# Autodesk Inventor assembly: WAS-Assembly
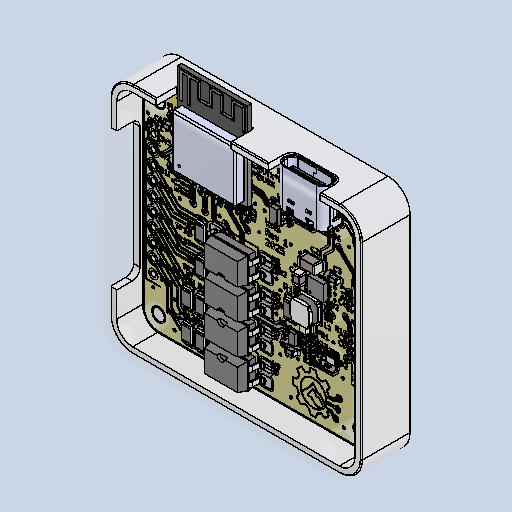
[picture p0: Inventor's stored thumbnail of the model, 512x512]
Saved by Autodesk Inventor 2027.1 (Build 311270010, 270A)
## iProperties
Created: 2025-09-30
Part Number: WAS-Assembly
Document SubType Name: Assembly
Designer: K. Paulsen
Author: K. Paulsen
## Documents named in this file (4)
- C:\repo\WAS\CAD\WAS-Assembly.iam
- C:\repo\WAS\CAD\WAS-PCB\WAS-PCB\WAS-PCB.iam
- C:\repo\WAS\CAD\WAS-Enclosure-Bottom.ipt
- C:\repo\WAS\CAD\WAS-Enclosure-Top.ipt
## Components (3 placed, 3 different names)
1. WAS-PCB:1 [sub-assembly] — Mate:1, Flush:1, Mate:2, Flush:4, Flush:5
2. WAS-Enclosure-Bottom:1 — Flush:2, Flush:3
3. WAS-Enclosure-Top:1 — Flush:3, Flush:4, Flush:5
## Relationships (7: Flush 5, Mate 2)
- Mate:1 (2 mm): WAS-PCB:1
- Flush:1: WAS-PCB:1
- Mate:2: WAS-PCB:1
- Flush:2: WAS-Enclosure-Bottom:1
- Flush:3: WAS-Enclosure-Bottom:1 ↔ WAS-Enclosure-Top:1
- Flush:4: WAS-PCB:1 ↔ WAS-Enclosure-Top:1
- Flush:5: WAS-PCB:1 ↔ WAS-Enclosure-Top:1
